# Autodesk Inventor assembly: Cantoneira perfil
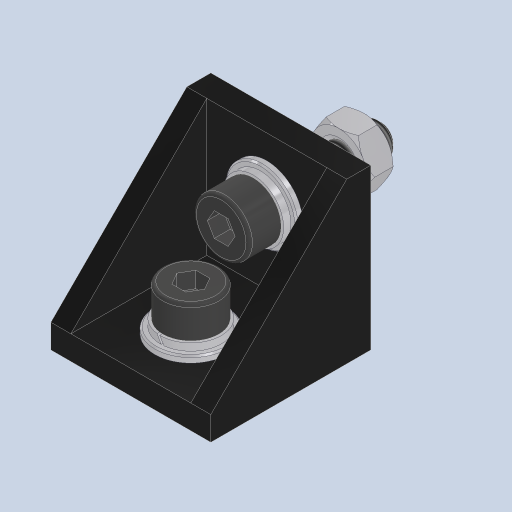
[picture p0: Inventor's stored thumbnail of the model, 512x512]
Saved by Autodesk Inventor 2024.3 (Build 283343000, 343)
## iProperties
Created: 2025-02-27
Part Number: Cantoneira perfil
Document SubType Name: Assembly
Designer: Cliente
Author: Cliente
## Documents named in this file (8)
- C:\Users\Cliente\Desktop\TCC\Base\Fixação\Cantoneira perfil.iam
- C:\Users\Cliente\Desktop\TCC\Base\Impresso\Cantoneira perfil.ipt
- C:\Users\Cliente\Desktop\TCC\Base\Fixação\Arruela lisa DIN 125 B M4.ipt
- C:\Users\Cliente\Desktop\TCC\Base\Fixação\Arruela de pressão DIN 127 B M4.ipt
- C:\Users\Cliente\Desktop\TCC\Base\Fixação\Parafuso allen cabeça cilíndrica DIN 912 M4x10.ipt
- C:\Users\Cliente\Desktop\TCC\Base\Fixação\Porca martelo M4 canal 6.ipt
- C:\Users\Cliente\Desktop\TCC\Base\Fixação\Porca sextavada DIN 934 M4.ipt
- C:\Users\Cliente\Desktop\TCC\Base\Fixação\Parafuso allen cabeça cilíndrica DIN 912 M4x16.ipt
## Components (9 placed, 7 different names)
1. Cantoneira perfil:1 — Alinhado:1, Alinhado:2, Alinhado:3, Coincidente:1, Coincidente:2, Coincidente:3, Coincidente:4, Ângulo:1, Ângulo:2, Ângulo:3, Ângulo:4, Ângulo:5, Ângulo:8, Coincidente:15, Ângulo:9, Coincidente:18, Ângulo:10
2. Arruela lisa DIN 125 B M4:1 — Coincidente:1, Coincidente:3, Ângulo:1, Coincidente:5, Coincidente:7
3. Arruela lisa DIN 125 B M4:2 — Coincidente:2, Coincidente:4, Ângulo:2, Coincidente:6, Coincidente:8
4. Arruela de pressão DIN 127 B M4:1 — Coincidente:5, Coincidente:7, Ângulo:3, Coincidente:9, Coincidente:12
5. Arruela de pressão DIN 127 B M4:2 — Coincidente:6, Coincidente:8, Ângulo:4, Coincidente:16, Coincidente:17
6. Parafuso allen cabeça cilíndrica DIN 912 M4x10:1 — Coincidente:9, Coincidente:12, Ângulo:5, Coincidente:13
7. Porca martelo M4 canal 6:1 — Coincidente:13, Ângulo:8, Coincidente:15
8. Parafuso allen cabeça cilíndrica DIN 912 M4x16:1 — Coincidente:16, Coincidente:17, Ângulo:9, Coincidente:19
9. Porca sextavada DIN 934 M4:1 — Coincidente:18, Coincidente:19, Ângulo:10
## Relationships (27: Mate 16, Angle 8, Flush 3)
- Alinhado:1 [Flush]: Cantoneira perfil:1
- Alinhado:2 [Flush]: Cantoneira perfil:1
- Alinhado:3 [Flush]: Cantoneira perfil:1
- Coincidente:1 [Mate]: Cantoneira perfil:1 ↔ Arruela lisa DIN 125 B M4:1
- Coincidente:2 [Mate]: Cantoneira perfil:1 ↔ Arruela lisa DIN 125 B M4:2
- Coincidente:3 [Mate]: Cantoneira perfil:1 ↔ Arruela lisa DIN 125 B M4:1
- Coincidente:4 [Mate]: Cantoneira perfil:1 ↔ Arruela lisa DIN 125 B M4:2
- Ângulo:1 [Angle] (0 deg): Cantoneira perfil:1 ↔ Arruela lisa DIN 125 B M4:1
- Ângulo:2 [Angle] (0 deg): Cantoneira perfil:1 ↔ Arruela lisa DIN 125 B M4:2
- Coincidente:5 [Mate]: Arruela lisa DIN 125 B M4:1 ↔ Arruela de pressão DIN 127 B M4:1
- Coincidente:6 [Mate]: Arruela lisa DIN 125 B M4:2 ↔ Arruela de pressão DIN 127 B M4:2
- Coincidente:7 [Mate]: Arruela lisa DIN 125 B M4:1 ↔ Arruela de pressão DIN 127 B M4:1
- Coincidente:8 [Mate]: Arruela lisa DIN 125 B M4:2 ↔ Arruela de pressão DIN 127 B M4:2
- Ângulo:3 [Angle] (0 deg): Cantoneira perfil:1 ↔ Arruela de pressão DIN 127 B M4:1
- Ângulo:4 [Angle] (0 deg): Cantoneira perfil:1 ↔ Arruela de pressão DIN 127 B M4:2
- Coincidente:9 [Mate]: Arruela de pressão DIN 127 B M4:1 ↔ Parafuso allen cabeça cilíndrica DIN 912 M4x10:1
- Coincidente:12 [Mate]: Arruela de pressão DIN 127 B M4:1 ↔ Parafuso allen cabeça cilíndrica DIN 912 M4x10:1
- Ângulo:5 [Angle] (0 deg): Cantoneira perfil:1 ↔ Parafuso allen cabeça cilíndrica DIN 912 M4x10:1
- Coincidente:13 [Mate]: Parafuso allen cabeça cilíndrica DIN 912 M4x10:1 ↔ Porca martelo M4 canal 6:1
- Ângulo:8 [Angle] (0 deg): Cantoneira perfil:1 ↔ Porca martelo M4 canal 6:1
- Coincidente:15 [Mate] (1.8 mm): Cantoneira perfil:1 ↔ Porca martelo M4 canal 6:1
- Coincidente:16 [Mate]: Arruela de pressão DIN 127 B M4:2 ↔ Parafuso allen cabeça cilíndrica DIN 912 M4x16:1
- Coincidente:17 [Mate]: Arruela de pressão DIN 127 B M4:2 ↔ Parafuso allen cabeça cilíndrica DIN 912 M4x16:1
- Ângulo:9 [Angle] (0 deg): Cantoneira perfil:1 ↔ Parafuso allen cabeça cilíndrica DIN 912 M4x16:1
- Coincidente:18 [Mate] (6 mm): Cantoneira perfil:1 ↔ Porca sextavada DIN 934 M4:1
- Coincidente:19 [Mate]: Parafuso allen cabeça cilíndrica DIN 912 M4x16:1 ↔ Porca sextavada DIN 934 M4:1
- Ângulo:10 [Angle] (0 deg): Cantoneira perfil:1 ↔ Porca sextavada DIN 934 M4:1
